# Autodesk Inventor assembly: BG006_thutrn22_26
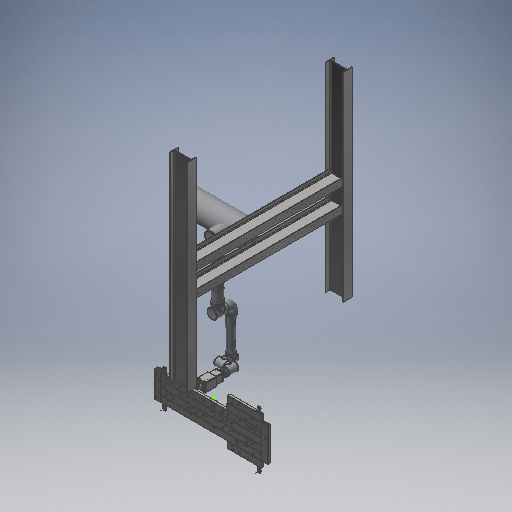
[picture p0: Inventor's stored thumbnail of the model, 512x512]
Saved by Autodesk Inventor 2025.3 (Build 293356000, 356)
## iProperties
Company: HTBLA Kaindorf
RuleStatus: InUse
Created: 2026-08-12
Part Number: BG006_thutrn22_26
Project: Biegeroboter
Material: Generisch
Description: biegekopf_gesamt_v2
Document SubType Name: Assembly
Designer: thutrn22
Mass: 555715 g
Surface Area: 194799 cm^2
Volume: 197252 cm^3
Density: 2.81728 g/cm^3
AfterDocNew0: iProperties-Editor_aufrufen
Author: trist
Keywords: 2026
## Documents named in this file (11)
- C:\Users\trist\Desktop\Schule\diplomarbeit_dateien\Mechanik\Biegekopf\BG006_thutrn22_26_Biegeroboter_biegekopf_gesamt_v2.iam
- C:\Users\trist\Desktop\Schule\diplomarbeit_dateien\Mechanik\Fairino FR20\Fairino FR20.iam
- C:\Users\trist\Desktop\Schule\diplomarbeit_dateien\Mechanik\Biegekopf\Gehäuse\BG004_thutrn22_26_Biegeroboter_biegekopf_gesamt_allein.iam
- C:\Users\trist\Desktop\Schule\diplomarbeit_dateien\Mechanik\Adapter\SCHUNK-0302201 A-SWK-020-ISO-A50.ipt
- C:\Users\trist\Desktop\Schule\diplomarbeit_dateien\Mechanik\ATC\AIS2024\SCHUNK-0302322 SWK-020-000-000, .iam
- C:\Users\trist\Desktop\Schule\diplomarbeit_dateien\Mechanik\Biegekopf\Verlängerung\BG003_thutrn22_26_Biegeroboter_verlängerung_gesamt_v2.iam
- C:\Users\trist\Desktop\Schule\diplomarbeit_dateien\Mechanik\Biegekopf\BT016_thutrn22_26_Biegeroboter_roboter_flansch.ipt
- C:\Users\trist\Desktop\Schule\diplomarbeit_dateien\Mechanik\Gesamtprojekt Biegelehre\Biegelehre\Biegelehre\Biegelehre.iam
- C:\Users\trist\Desktop\Schule\diplomarbeit_dateien\Mechanik\Biegekopf\Deckenkonstruktion\BG004_bensen22_26_Biegeroboter_deckenkonstruktion_gesamt_v1.iam
- C:\Users\trist\Documents\Inventor\Content Center Files\R2025\de-DE\DIN EN 1667\DIN EN 1667 - M10 x 1.ipt
- C:\Users\trist\Documents\Inventor\Content Center Files\R2025\de-DE\ISO 4014(1)\ISO 4014 - M10 x 55DIN EN.ipt
## Components (20 placed, 10 different names)
1. Fairino FR20:1 [sub-assembly] — Passend:1, Passend:2, Passend:3, Passend:4, Passend:5, Passend:7, Passend:8, Passend:9, Passend:15, Passend:16, Einfügen:2, Einfügen:8, Passend:18, Passend:19, Einfügen:15, Einfügen:16, Einfügen:17
2. BG004_thutrn22_26_Biegeroboter_biegekopf_gesamt_allein:1 [sub-assembly] — Passend:10, Passend:11, Passend:12, Passend:13, Passend:14
3. SCHUNK-0302201 A-SWK-020-ISO-A50:1 — Passend:1, Passend:2, Passend:3, Passend:4, Passend:5, Passend:6
4. SCHUNK-0302322 SWK-020-000-000, :1 [sub-assembly] — Passend:6, Passend:7, Passend:8, Passend:9, Passend:10, Passend:11, Passend:12
5. BG003_thutrn22_26_Biegeroboter_verlängerung_gesamt_v2:1 [sub-assembly] — Passend:13, Passend:14, Einfügen:1
6. BT016_thutrn22_26_Biegeroboter_roboter_flansch:1 — Passend:15, Passend:16, Passend:17, Einfügen:18, Einfügen:19, Einfügen:20, Einfügen:21, Einfügen:22, Einfügen:23
7. Biegelehre:1 [sub-assembly] — Einfügen:1
8. BG004_bensen22_26_Biegeroboter_deckenkonstruktion_gesamt_v1:1 [sub-assembly] — Passend:17
9. DIN EN 24014 M10 x 55:1 — Einfügen:2
10. DIN EN 24014 M10 x 55:2 — Einfügen:8
11. DIN EN 24014 M10 x 55:3 — Passend:18, Passend:19
12. DIN EN 24014 M10 x 55:5 — Einfügen:15
13. DIN EN 24014 M10 x 55:4 — Einfügen:16
14. DIN EN 24014 M10 x 55:6 — Einfügen:17
15. DIN EN 1667 M10 x 1:1 — Einfügen:18
16. DIN EN 1667 M10 x 1:2 — Einfügen:19
17. DIN EN 1667 M10 x 1:3 — Einfügen:20
18. DIN EN 1667 M10 x 1:4 — Einfügen:21
19. DIN EN 1667 M10 x 1:5 — Einfügen:22
20. DIN EN 1667 M10 x 1:6 — Einfügen:23
## Relationships (31: Mate 19, Insert 12)
- Passend:1 [Mate]: Fairino FR20:1 ↔ SCHUNK-0302201 A-SWK-020-ISO-A50:1
- Passend:2 [Mate]: Fairino FR20:1 ↔ SCHUNK-0302201 A-SWK-020-ISO-A50:1
- Passend:3 [Mate]: Fairino FR20:1 ↔ SCHUNK-0302201 A-SWK-020-ISO-A50:1
- Passend:4 [Mate]: Fairino FR20:1 ↔ SCHUNK-0302201 A-SWK-020-ISO-A50:1
- Passend:5 [Mate]: Fairino FR20:1 ↔ SCHUNK-0302201 A-SWK-020-ISO-A50:1
- Passend:6 [Mate]: SCHUNK-0302201 A-SWK-020-ISO-A50:1 ↔ SCHUNK-0302322 SWK-020-000-000, :1
- Passend:7 [Mate]: Fairino FR20:1 ↔ SCHUNK-0302322 SWK-020-000-000, :1
- Passend:8 [Mate]: Fairino FR20:1 ↔ SCHUNK-0302322 SWK-020-000-000, :1
- Passend:9 [Mate]: Fairino FR20:1 ↔ SCHUNK-0302322 SWK-020-000-000, :1
- Passend:10 [Mate]: BG004_thutrn22_26_Biegeroboter_biegekopf_gesamt_allein:1 ↔ SCHUNK-0302322 SWK-020-000-000, :1
- Passend:11 [Mate]: BG004_thutrn22_26_Biegeroboter_biegekopf_gesamt_allein:1 ↔ SCHUNK-0302322 SWK-020-000-000, :1
- Passend:12 [Mate]: BG004_thutrn22_26_Biegeroboter_biegekopf_gesamt_allein:1 ↔ SCHUNK-0302322 SWK-020-000-000, :1
- Passend:13 [Mate]: BG004_thutrn22_26_Biegeroboter_biegekopf_gesamt_allein:1 ↔ BG003_thutrn22_26_Biegeroboter_verlängerung_gesamt_v2:1
- Passend:14 [Mate]: BG004_thutrn22_26_Biegeroboter_biegekopf_gesamt_allein:1 ↔ BG003_thutrn22_26_Biegeroboter_verlängerung_gesamt_v2:1
- Passend:15 [Mate]: Fairino FR20:1 ↔ BT016_thutrn22_26_Biegeroboter_roboter_flansch:1
- Passend:16 [Mate]: Fairino FR20:1 ↔ BT016_thutrn22_26_Biegeroboter_roboter_flansch:1
- Einfügen:1 [Insert]: BG003_thutrn22_26_Biegeroboter_verlängerung_gesamt_v2:1 ↔ Biegelehre:1
- Passend:17 [Mate] (-232.95 mm): BT016_thutrn22_26_Biegeroboter_roboter_flansch:1 ↔ BG004_bensen22_26_Biegeroboter_deckenkonstruktion_gesamt_v1:1
- Einfügen:2 [Insert]: Fairino FR20:1 ↔ DIN EN 24014 M10 x 55:1
- Einfügen:8 [Insert]: Fairino FR20:1 ↔ DIN EN 24014 M10 x 55:2
- Passend:18 [Mate]: Fairino FR20:1 ↔ DIN EN 24014 M10 x 55:3
- Passend:19 [Mate]: Fairino FR20:1 ↔ DIN EN 24014 M10 x 55:3
- Einfügen:15 [Insert]: Fairino FR20:1 ↔ DIN EN 24014 M10 x 55:5
- Einfügen:16 [Insert]: Fairino FR20:1 ↔ DIN EN 24014 M10 x 55:4
- Einfügen:17 [Insert]: Fairino FR20:1 ↔ DIN EN 24014 M10 x 55:6
- Einfügen:18 [Insert]: BT016_thutrn22_26_Biegeroboter_roboter_flansch:1 ↔ DIN EN 1667 M10 x 1:1
- Einfügen:19 [Insert]: BT016_thutrn22_26_Biegeroboter_roboter_flansch:1 ↔ DIN EN 1667 M10 x 1:2
- Einfügen:20 [Insert]: BT016_thutrn22_26_Biegeroboter_roboter_flansch:1 ↔ DIN EN 1667 M10 x 1:3
- Einfügen:21 [Insert]: BT016_thutrn22_26_Biegeroboter_roboter_flansch:1 ↔ DIN EN 1667 M10 x 1:4
- Einfügen:22 [Insert]: BT016_thutrn22_26_Biegeroboter_roboter_flansch:1 ↔ DIN EN 1667 M10 x 1:5
- Einfügen:23 [Insert]: BT016_thutrn22_26_Biegeroboter_roboter_flansch:1 ↔ DIN EN 1667 M10 x 1:6
